# Autodesk Inventor assembly: RDS-SPF-3-200-0000 Reagent Dosing Station
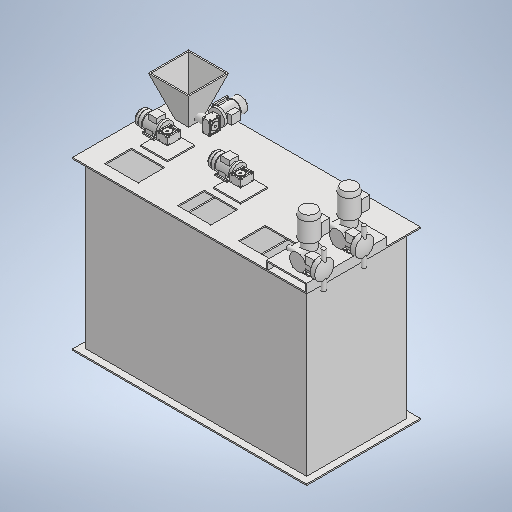
[picture p0: Inventor's stored thumbnail of the model, 512x512]
Saved by Autodesk Inventor 2026.2 (Build 302298000, 298)
## iProperties
Created: 2026-10-28
Part Number: RDS-SPF-3-200-0000 Reagent Dosing Station
Document SubType Name: Assembly
Designer: user
Mass: 143900 g
Surface Area: 257835 cm^2
Volume: 143900 cm^3
Density: 1 g/cm^3
Author: user
## Documents named in this file (7)
- C:\Users\admin\Documents\Inventor\PRF-Parfino\RDS-SPF-3-200 Reagent Dosing Station\RDS-SPF-3-200-0000 Reagent Dosing Station.iam
- C:\Users\admin\Documents\Inventor\PRF-Parfino\RDS-SPF-3-200 Reagent Dosing Station\RDS-SPF-3-200-1000 Tank.ipt
- C:\Users\admin\Documents\Inventor\PRF-Parfino\Старые модели\СДР 050 Дозатор реагента.ipt
- C:\Users\admin\Documents\Inventor\PRF-Parfino\Старые модели\СДР 060 Мотор-редуктор 2.0.ipt
- C:\Users\admin\Documents\Inventor\PRF-Parfino\RDS-SPF-2-120 Reagent Dosing Station\RDS-SPF-2-120-2000 hopper.ipt
- C:\Users\admin\Documents\Inventor\PRF-Parfino\Старые модели\СДР 060 Мотор-редуктор.ipt
- C:\Users\admin\Documents\Inventor\PRF-Parfino\RDS-SPF-2-120 Reagent Dosing Station\RDS-SPF-2-120-2001 bush.ipt
## Components (8 placed, 6 different names)
1. RDS-SPF-3-200-1000 Tank:1 — Mate:1, Flush:1, Flush:2, Mate:2, Flush:3, Flush:4, Rotational:1, Rotational:2, Mate:3, Mate:4
2. СДР 050 Дозатор реагента:1 — Mate:1, Flush:1, Flush:2
3. СДР 050 Дозатор реагента:2 — Mate:2, Flush:3, Flush:4
4. СДР 060 Мотор-редуктор 2.0:1 — Rotational:1
5. СДР 060 Мотор-редуктор 2.0:2 — Rotational:2
6. RDS-SPF-2-120-2000 hopper:1 — Mate:3
7. СДР 060 Мотор-редуктор:1 — Mate:4, Rotational:3
8. RDS-SPF-2-120-2001 bush:1 — Rotational:3
## Relationships (11: Mate 4, Flush 4, RevoluteJoint 3)
- Mate:1: RDS-SPF-3-200-1000 Tank:1 ↔ СДР 050 Дозатор реагента:1
- Flush:1 (30 mm): RDS-SPF-3-200-1000 Tank:1 ↔ СДР 050 Дозатор реагента:1
- Flush:2 (50 mm): RDS-SPF-3-200-1000 Tank:1 ↔ СДР 050 Дозатор реагента:1
- Mate:2: RDS-SPF-3-200-1000 Tank:1 ↔ СДР 050 Дозатор реагента:2
- Flush:3 (30 mm): RDS-SPF-3-200-1000 Tank:1 ↔ СДР 050 Дозатор реагента:2
- Flush:4 (350 mm): RDS-SPF-3-200-1000 Tank:1 ↔ СДР 050 Дозатор реагента:2
- Rotational:1 [RevoluteJoint] (30 mm): RDS-SPF-3-200-1000 Tank:1 ↔ СДР 060 Мотор-редуктор 2.0:1
- Rotational:2 [RevoluteJoint] (30 mm): RDS-SPF-3-200-1000 Tank:1 ↔ СДР 060 Мотор-редуктор 2.0:2
- Mate:3: RDS-SPF-3-200-1000 Tank:1 ↔ RDS-SPF-2-120-2000 hopper:1
- Mate:4: RDS-SPF-3-200-1000 Tank:1 ↔ СДР 060 Мотор-редуктор:1
- Rotational:3 [RevoluteJoint]: СДР 060 Мотор-редуктор:1 ↔ RDS-SPF-2-120-2001 bush:1
